# Autodesk Inventor assembly: 3508_low_res
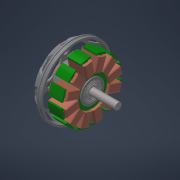
[picture p0: Inventor's stored thumbnail of the model, 180x180]
Saved by Autodesk Inventor 2021 (Build 250183000, 183)
## iProperties
Created: 2021-05-24
Part Number: 3508_low_res
Document SubType Name: Assembly
Designer: Administrator
motor: 70.00 deg
Title: 3508_low_res v1
Author: Administrator
## Documents named in this file (7)
- D:\Experimen\Inventor\BAYUCARAKA\Tarot\MN 3508\3508_low_res.iam
- D:\Experimen\Inventor\BAYUCARAKA\Tarot\MN 3508\stator.ipt
- D:\Experimen\Inventor\BAYUCARAKA\Tarot\MN 3508\R1140ZZ bearing.ipt
- D:\Experimen\Inventor\BAYUCARAKA\Tarot\MN 3508\coil_green_low_res.ipt
- D:\Experimen\Inventor\BAYUCARAKA\Tarot\MN 3508\bell.ipt
- D:\Experimen\Inventor\BAYUCARAKA\Tarot\MN 3508\axle.ipt
- D:\Experimen\Inventor\BAYUCARAKA\Tarot\MN 3508\circlip.ipt
## Components (7 placed, 6 different names)
1. stator:1 — Mate:1
2. R1140ZZ bearing:1
3. R1140ZZ bearing:2
4. coil_green_low_res:1
5. bell:1 — Mate:1, Mate:2, Angle:1
6. axle:1 — Mate:2, Angle:1
7. circlip:1
## Relationships (3: Mate 2, Angle 1)
- Mate:1 (0.566 mm): stator:1 ↔ bell:1
- Mate:2: bell:1 ↔ axle:1
- Angle:1: bell:1 ↔ axle:1
